# Autodesk Inventor assembly: tensiton1
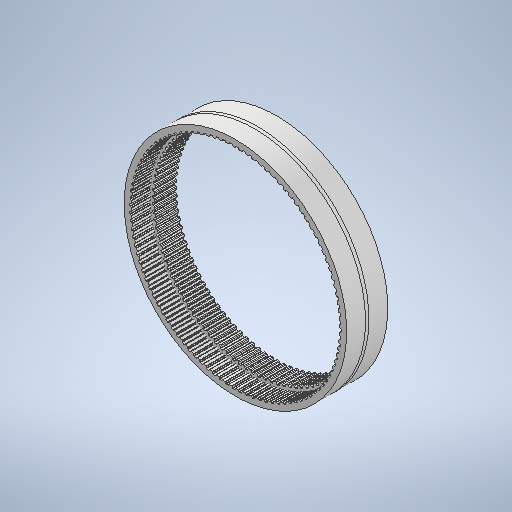
[picture p0: Inventor's stored thumbnail of the model, 512x512]
Saved by Autodesk Inventor 2025.3 (Build 293356030, 356C)
## iProperties
Created: 2026-02-24
Part Number: tensiton1
Document SubType Name: Assembly
Designer: ibuki_ono
Author: ibuki_ono
## Documents named in this file (3)
- C:\Users\ibuki_ono\Documents\hobby\rogiken\catchrobo\2026_CAD\Hardware_2026\Inventor\belt\tensiton1.iam
- C:\Users\ibuki_ono\Documents\hobby\rogiken\catchrobo\2026_CAD\Hardware_2026\Inventor\belt\3D_belt-MXL-100.ipt
- C:\Users\ibuki_ono\Documents\hobby\rogiken\catchrobo\2026_CAD\Hardware_2026\Inventor\belt\3D_belt-MXL-100-num.ipt
## Components (2 placed, 2 different names)
1. 3D_belt-MXL-100:1 — メイト:1, メイト:2, メイト:3
2. 3D_belt-MXL-100-num:1 — メイト:1, メイト:4, メイト:5
## Relationships (5: Mate 5)
- メイト:1 [Mate]: 3D_belt-MXL-100:1 ↔ 3D_belt-MXL-100-num:1
- メイト:2 [Mate]: 3D_belt-MXL-100:1
- メイト:3 [Mate]: 3D_belt-MXL-100:1
- メイト:4 [Mate]: 3D_belt-MXL-100-num:1
- メイト:5 [Mate]: 3D_belt-MXL-100-num:1
